# Autodesk Inventor assembly: DM-J4340
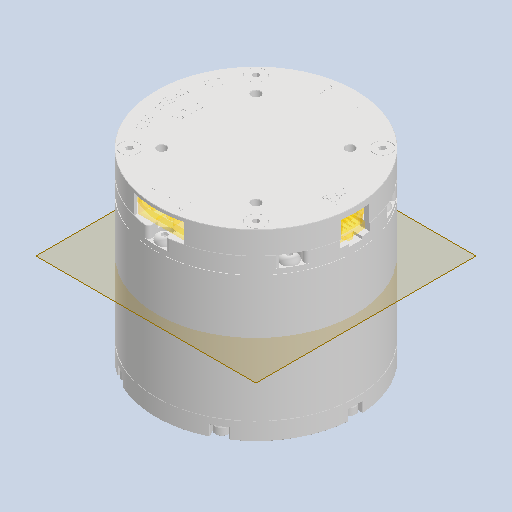
[picture p0: Inventor's stored thumbnail of the model, 512x512]
Saved by Autodesk Inventor 2025.3 (Build 293356000, 356)
## iProperties
Created: 2026-03-25
Part Number: DM-J4340
Document SubType Name: Assembly
Designer: Admin
Sending System: CREO PARAMETRIC BY PTC INC, 2020053
Preprocessor: CREO PARAMETRIC BY PTC INC, 2020053
Title: DM_4340__3D20240325_1_4
Author: rw
Revision Number: 1LAST_VERSION
## Documents named in this file (10)
- C:\Users\shfzf\Desktop\FEIBOT\ROBOT_CAD\DM-J4340\DM-J4340.iam
- C:\Users\shfzf\Desktop\FEIBOT\ROBOT_CAD\DM-J4340\DM_4340_3D_1_1_1_1_4.ipt
- C:\Users\shfzf\Desktop\FEIBOT\ROBOT_CAD\DM-J4340\4340__3D_20240814_1_2_4.ipt
- C:\Users\shfzf\Desktop\FEIBOT\ROBOT_CAD\DM-J4340\4310_202409130001.ipt
- C:\Users\shfzf\Desktop\FEIBOT\ROBOT_CAD\DM-J4340\G43_V1_1_3-230824_4.ipt
- C:\Users\shfzf\Desktop\FEIBOT\ROBOT_CAD\DM-J4340\4040V300.ipt
- C:\Users\shfzf\Desktop\FEIBOT\ROBOT_CAD\DM-J4340\M2_5-800.ipt
- C:\Users\shfzf\Desktop\FEIBOT\ROBOT_CAD\DM-J4340\M2_5-L4.ipt
- C:\Users\shfzf\Desktop\FEIBOT\ROBOT_CAD\DM-J4340\M2_5-L6.ipt
- C:\Users\shfzf\Desktop\FEIBOT\ROBOT_CAD\DM-J4340\_M2_5-100001.ipt
## Components (26 placed, 26 different names)
1. DM_4340_3D_1_1_1_1_4_0
2. 4340__3D_20240814_1_2_4_1
3. 4310_202409130001_2
4. G43_V1_1_3-230824_4_3
5. 4040V300_4 — 表面齐平:1
6. M2_5-800_5
7. M2_5-800_6
8. M2_5-800_7
9. M2_5-800_8
10. M2_5-800_9
11. M2_5-800_10
12. M2_5-L4_11
13. M2_5-L4_12
14. M2_5-L4_13
15. M2_5-L4_14
16. M2_5-L6_15
17. M2_5-L6_16
18. M2_5-L6_17
19. M2_5-L6_18
20. M2_5-L6_19
21. M2_5-L6_20
22. M2_5-L6_21
23. _M2_5-100001_22
24. _M2_5-100001_23
25. _M2_5-100001_24
26. _M2_5-100001_25
## Relationships (1: Flush 1)
- 表面齐平:1 [Flush] (-26.65 mm): 4040V300_4
